# Autodesk Inventor assembly: 6_11_asm_detection3
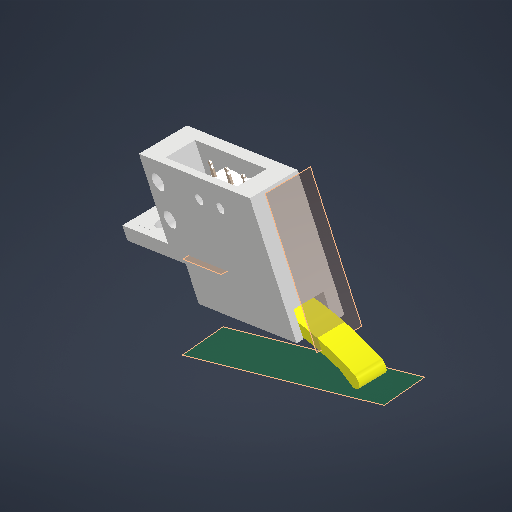
[picture p0: Inventor's stored thumbnail of the model, 512x512]
Saved by Autodesk Inventor 2026 (Build 300175000, 175)
## iProperties
Created: 2025-06-19
Part Number: 6_11_asm_detection3
Document SubType Name: Assembly
Designer: Diogo
Author: Diogo
## Documents named in this file (6)
- C:\Users\virgi\OneDrive - HESSO\Fichiers de Guerinet Rémi - P2511_Dossier_partage_RVEZ\01_Robot\0101_CAO\6_Detection\6_11_asm_detection3.iam
- C:\Users\virgi\OneDrive - HESSO\Fichiers de Guerinet Rémi - P2511_Dossier_partage_RVEZ\01_Robot\0101_CAO\6_Detection\6_08_support_detection3.ipt
- C:\Users\virgi\OneDrive - HESSO\Fichiers de Guerinet Rémi - P2511_Dossier_partage_RVEZ\01_Robot\0101_CAO\6_Detection\6_09_plaque_supp_detection3.ipt
- C:\Users\virgi\OneDrive - HESSO\Fichiers de Guerinet Rémi - P2511_Dossier_partage_RVEZ\01_Robot\0101_CAO\6_Detection\DM1_Series_Switch\STEP\DM1-02P-30-3\DM1-02P-30-3\DM1-02P-30-3.ipt
- C:\Users\virgi\OneDrive - HESSO\Fichiers de Guerinet Rémi - P2511_Dossier_partage_RVEZ\01_Robot\0101_CAO\6_Detection\6_11_piece_mobile_detection4.ipt
- C:\Users\virgi\OneDrive - HESSO\Fichiers de Guerinet Rémi - P2511_Dossier_partage_RVEZ\01_Robot\0101_CAO\6_Detection\6_12_piece_mobile_detection5.ipt
## Components (6 placed, 5 different names)
1. 6_08_support_detection3:1 — Placage:1, Affleurement:1, Affleurement:2, Angle:1, Placage:8, Placage:9, Affleurement:4, Placage:10, Placage:11, Placage:12, Placage:15, Placage:16, Placage:17, Placage:18, Placage:19
2. 6_09_plaque_supp_detection3:1 — Placage:1, Affleurement:1, Affleurement:2
3. DM1-02P-30-3:1 — Placage:8, Placage:9, Placage:15
4. 6_11_piece_mobile_detection4:1 — Placage:10, Placage:11, Placage:12, Tangente:1
5. 6_12_piece_mobile_detection5:1 — Placage:18, Placage:19, Tangente:1
6. 6_09_plaque_supp_detection3:2 — Placage:16, Placage:17
## Relationships (16: Mate 11, Flush 3, Angle 1, Tangent 1)
- Placage:1 [Mate]: 6_08_support_detection3:1 ↔ 6_09_plaque_supp_detection3:1
- Affleurement:1 [Flush]: 6_08_support_detection3:1 ↔ 6_09_plaque_supp_detection3:1
- Affleurement:2 [Flush]: 6_08_support_detection3:1 ↔ 6_09_plaque_supp_detection3:1
- Angle:1 (0 deg): 6_08_support_detection3:1
- Placage:8 [Mate]: 6_08_support_detection3:1 ↔ DM1-02P-30-3:1
- Placage:9 [Mate]: 6_08_support_detection3:1 ↔ DM1-02P-30-3:1
- Affleurement:4 [Flush] (10 mm): 6_08_support_detection3:1
- Placage:10 [Mate]: 6_08_support_detection3:1 ↔ 6_11_piece_mobile_detection4:1
- Placage:11 [Mate]: 6_08_support_detection3:1 ↔ 6_11_piece_mobile_detection4:1
- Placage:12 [Mate]: 6_08_support_detection3:1 ↔ 6_11_piece_mobile_detection4:1
- Placage:15 [Mate]: 6_08_support_detection3:1 ↔ DM1-02P-30-3:1
- Placage:16 [Mate]: 6_08_support_detection3:1 ↔ 6_09_plaque_supp_detection3:2
- Placage:17 [Mate]: 6_08_support_detection3:1 ↔ 6_09_plaque_supp_detection3:2
- Placage:18 [Mate]: 6_08_support_detection3:1 ↔ 6_12_piece_mobile_detection5:1
- Placage:19 [Mate]: 6_08_support_detection3:1 ↔ 6_12_piece_mobile_detection5:1
- Tangente:1: 6_11_piece_mobile_detection4:1 ↔ 6_12_piece_mobile_detection5:1
